# Autodesk Inventor assembly: MainBody_Assembly
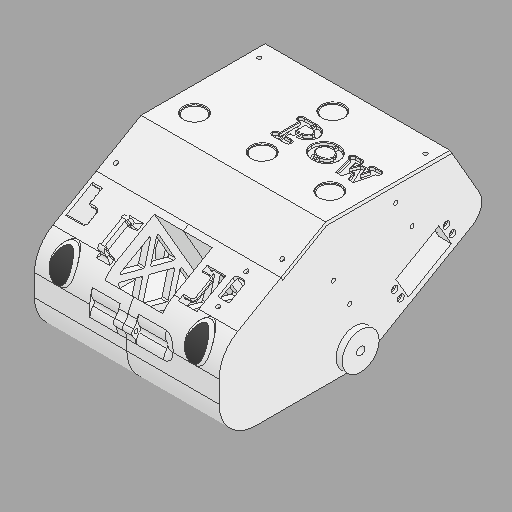
[picture p0: Inventor's stored thumbnail of the model, 512x512]
Saved by Autodesk Inventor 2025 (Build 290162000, 162)
## iProperties
Created: 2024-11-15
Part Number: MainBody_Assembly
Document SubType Name: Assembly
Designer: OSB
Mass: 1414.04 g
Surface Area: 4558.62 cm^2
Volume: 1064.8 cm^3
Density: 1.32799 g/cm^3
Sending System: Autodesk Inventor 2021
Preprocessor: unknown
Minimum Resolution: 0.01
Sent Units: Millimeter
Translation Standard: IGES 5.3
Model Creation Time: 2020-07-07
Title: S500 Frame
Author: OSB
## Documents named in this file (4)
- C:\Users\OSB\Desktop\SB\1.Projects\캡스톤 디자인(2)_Paper\Modeling\Implementation_Design\Ver_003_mass_update\MainBody_Assembly_Collision.iam
- C:\Users\OSB\Desktop\SB\1.Projects\캡스톤 디자인(2)_Paper\Modeling\Implementation_Design\Ver_003_mass_update\MainBody_Left.ipt
- C:\Users\OSB\Desktop\SB\1.Projects\캡스톤 디자인(2)_Paper\Modeling\Implementation_Design\Ver_003_mass_update\MainBody_Right.ipt
- C:\Users\OSB\Desktop\SB\1.Projects\캡스톤 디자인(2)_Paper\Modeling\Implementation_Design\Ver_003_mass_update\MainBody_TopCover.ipt
## Components (3 placed, 3 different names)
1. MainBody_Left:1 — 회전:1, 메이트:1
2. MainBody_Right:1 — 회전:1, 메이트:1
3. MainBody_TopCover:1
## Relationships (2: RevoluteJoint 1, Mate 1)
- 회전:1 [RevoluteJoint]: MainBody_Left:1 ↔ MainBody_Right:1
- 메이트:1 [Mate]: MainBody_Left:1 ↔ MainBody_Right:1
